# Autodesk Inventor assembly: roda diferencial
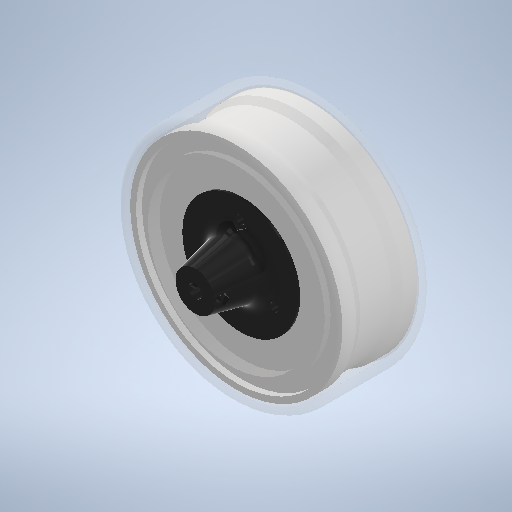
[picture p0: Inventor's stored thumbnail of the model, 512x512]
Saved by Autodesk Inventor 2025.2 (Build 292293000, 293)
## iProperties
Created: 2026-06-02
Part Number: roda diferencial
Document SubType Name: Assembly
Designer: joaoc
Author: joaoc
## iProperties of the stored document roda normal.ipt
Created: 2026-06-02
Part Number: roda normal
Material: Generic
Description: STEP AP203
Document SubType Name: Modeling
Designer: joaoc
Density: 1 g/cm^3
Appearance: Default
Sending System: SolidWorks 2023
Preprocessor: SwSTEP 2.0
Title: roda normal.STEP
Revision Number: ANY
## iProperties of the stored document Acoplamento motor roda V2.ipt
Created: 2025-01-07
Part Number: Acoplamento motor roda V2
Material: ABS Plastic
Document SubType Name: Modeling
Designer: Cliente
Mass: 17.616 g
Surface Area: 80.0658 cm^2
Volume: 19.1063 cm^3
Density: 0.922 g/cm^3
Appearance: Default
Sending System: Autodesk Inventor 2026
Author: Cliente
## iProperties of the stored document pneu.ipt
Created: 2026-06-02
Part Number: pneu
Material: Generic
Description: STEP AP203
Document SubType Name: Modeling
Designer: joaoc
Density: 1 g/cm^3
Appearance: Default
Sending System: SolidWorks 2023
Preprocessor: SwSTEP 2.0
Title: pneu.STEP
Revision Number: ANY
## Documents named in this file (7)
- C:\Users\joaoc\Documents\montagem omnicare final\roda dif\roda diferencial.iam
- **C:\Users\joaoc\Documents\montagem omnicare final\roda dif\roda diferencial.iam*LocalDocs*xAaaaqmcaAaaaaaaaAaaaad230f*roda normal.ipt
- **C:\Users\joaoc\Documents\montagem omnicare final\roda dif\roda diferencial.iam*LocalDocs*xAaaaqodaAaaaaaaaAaaaa2nz4f*pneu.ipt
- **C:\Users\joaoc\Documents\montagem omnicare final\roda dif\roda diferencial.iam*LocalDocs*xAaaaqadaAaaaaaaaAaaaaqfkXc*Acoplamento motor roda V2.ipt
- C:\Users\joaoc\Documents\montagem omnicare final\Roda\Acoplamento motor roda V2.ipt
- C:\Users\joaoc\Documents\montagem omnicare final\roda dif\roda normal.STEP
- C:\Users\joaoc\Documents\montagem omnicare final\roda dif\pneu.STEP
## Components (3 placed, 3 different names)
1. roda normal:1 — Insert:1, Insert:2
2. pneu:1 — Insert:2
3. Acoplamento motor roda V2:1 — Insert:1
## Relationships (2: Insert 2)
- Insert:1: roda normal:1 ↔ Acoplamento motor roda V2:1
- Insert:2: roda normal:1 ↔ pneu:1
